# Autodesk Inventor assembly: BG008_bensen22_26
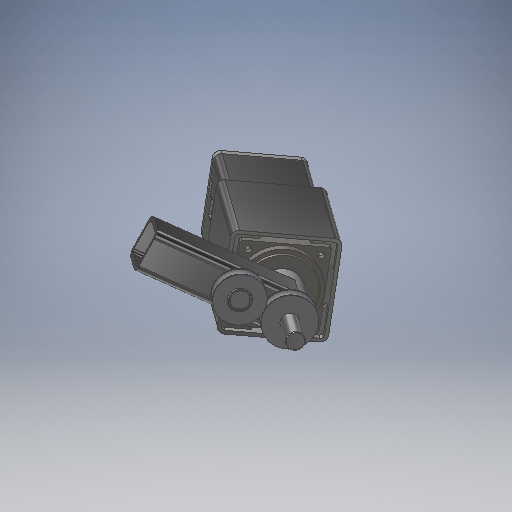
[picture p0: Inventor's stored thumbnail of the model, 512x512]
Saved by Autodesk Inventor 2025 (Build 290162000, 162)
## iProperties
Company: HTBLA Kaindorf
RuleStatus: InUse
Created: 2026-08-13
Part Number: BG008_bensen22_26
Project: Biegeroboter
Material: Generisch
Description: gehäuse_verlängerung_v1
Document SubType Name: Assembly
Designer: bensen22
Mass: 10895 g
Surface Area: 7242.58 cm^2
Volume: 3840.48 cm^3
Density: 2.83688 g/cm^3
AfterDocNew0: iProperties-Editor_aufrufen
Author: sebas
Keywords: 2026
## Documents named in this file (3)
- C:\Users\sebas\Desktop\Schule\HTBLA Kaindorf\diplomarbeit_dateien\Mechanik\Biegekopf\Gehäuse\BG008_bensen22_26_Biegeroboter_gehäuse_verlängerung_v1.iam
- C:\Users\sebas\Desktop\Schule\HTBLA Kaindorf\diplomarbeit_dateien\Mechanik\Biegekopf\Gehäuse\BG004_thutrn22_26_Biegeroboter_biegekopf_gesamt_allein.iam
- C:\Users\sebas\Desktop\Schule\HTBLA Kaindorf\diplomarbeit_dateien\Mechanik\Biegekopf\Verlängerung\BG003_thutrn22_26_Biegeroboter_verlängerung_gesamt_v2.iam
## Components (2 placed, 2 different names)
1. BG004_thutrn22_26_Biegeroboter_biegekopf_gesamt_allein:1 [sub-assembly] — Passend:2, Passend:3
2. BG003_thutrn22_26_Biegeroboter_verlängerung_gesamt_v2:1 [sub-assembly] — Passend:2, Passend:3
## Relationships (2: Mate 2)
- Passend:2 [Mate]: BG004_thutrn22_26_Biegeroboter_biegekopf_gesamt_allein:1 ↔ BG003_thutrn22_26_Biegeroboter_verlängerung_gesamt_v2:1
- Passend:3 [Mate]: BG004_thutrn22_26_Biegeroboter_biegekopf_gesamt_allein:1 ↔ BG003_thutrn22_26_Biegeroboter_verlängerung_gesamt_v2:1
